# Autodesk Inventor assembly: Assembly3
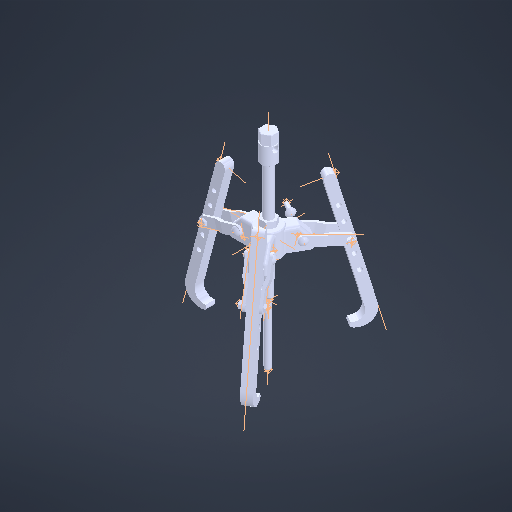
[picture p0: Inventor's stored thumbnail of the model, 512x512]
Saved by Autodesk Inventor 2025.4 (Build 294407000, 407)
## iProperties
Created: 2026-06-25
Part Number: Assembly3
Document SubType Name: Assembly
Designer: VuQuan
Author: VuQuan
## Documents named in this file (9)
- D:\Edu\4CHaUI-Inventor\Test3D\Assembly3.iam
- D:\Edu\4CHaUI-Inventor\Test3D\Bolt.ipt
- D:\Edu\4CHaUI-Inventor\Test3D\Carrier Arm Wheel.ipt
- D:\Edu\4CHaUI-Inventor\Test3D\Handle.ipt
- D:\Edu\4CHaUI-Inventor\Test3D\Hub.ipt
- D:\Edu\4CHaUI-Inventor\Test3D\Locking bar.ipt
- D:\Edu\4CHaUI-Inventor\Test3D\Nut.ipt
- D:\Edu\4CHaUI-Inventor\Test3D\Puller Jaw.ipt
- D:\Edu\4CHaUI-Inventor\Test3D\Screw.ipt
## Components (25 placed, 8 different names)
1. Bolt:1 — Insert:10
2. Carrier Arm Wheel:1 — Insert:2, Insert:7, Insert:11, Insert:21
3. Handle:1
4. Hub:1 — Mate:1, Insert:1, Insert:2, Insert:3, Insert:4, Insert:5, Insert:6
5. Locking bar:1 — Insert:16
6. Nut:1 — Insert:14
7. Puller Jaw:1 — Insert:7, Mate:4
8. Screw:1 — Mate:1
9. Carrier Arm Wheel:2 — Insert:4, Mate:4, Insert:14, Insert:20
10. Carrier Arm Wheel:3 — Insert:5, Insert:8, Insert:12, Insert:17
11. Carrier Arm Wheel:4 — Insert:3, Insert:9, Insert:10, Insert:19
12. Carrier Arm Wheel:5 — Insert:6, Mate:2, Insert:15, Insert:18
13. Carrier Arm Wheel:6 — Insert:1, Mate:3, Insert:13, Insert:16
14. Puller Jaw:2 — Insert:8, Mate:3
15. Puller Jaw:3 — Insert:9, Mate:2
16. Bolt:2 — Insert:12
17. Bolt:3 — Insert:11
18. Nut:2 — Insert:13
19. Nut:3 — Insert:15
20. Locking bar:2 — Insert:17
21. Locking bar:3 — Insert:18
22. Locking bar:4 — Insert:20
23. Locking bar:5
24. Locking bar:6 — Insert:19
25. Locking bar:7 — Insert:21
## Relationships (25: Insert 21, Mate 4)
- Mate:1: Hub:1 ↔ Screw:1
- Insert:1: Hub:1 ↔ Carrier Arm Wheel:6
- Insert:2: Carrier Arm Wheel:1 ↔ Hub:1
- Insert:3: Hub:1 ↔ Carrier Arm Wheel:4
- Insert:4: Hub:1 ↔ Carrier Arm Wheel:2
- Insert:5: Hub:1 ↔ Carrier Arm Wheel:3
- Insert:6: Hub:1 ↔ Carrier Arm Wheel:5
- Insert:7: Carrier Arm Wheel:1 ↔ Puller Jaw:1
- Insert:8: Carrier Arm Wheel:3 ↔ Puller Jaw:2
- Insert:9: Carrier Arm Wheel:4 ↔ Puller Jaw:3
- Mate:2: Carrier Arm Wheel:5 ↔ Puller Jaw:3
- Mate:3: Carrier Arm Wheel:6 ↔ Puller Jaw:2
- Mate:4: Puller Jaw:1 ↔ Carrier Arm Wheel:2
- Insert:10: Bolt:1 ↔ Carrier Arm Wheel:4
- Insert:11: Carrier Arm Wheel:1 ↔ Bolt:3
- Insert:12: Carrier Arm Wheel:3 ↔ Bolt:2
- Insert:13: Carrier Arm Wheel:6 ↔ Nut:2
- Insert:14: Nut:1 ↔ Carrier Arm Wheel:2
- Insert:15: Carrier Arm Wheel:5 ↔ Nut:3
- Insert:16: Locking bar:1 ↔ Carrier Arm Wheel:6
- Insert:17: Carrier Arm Wheel:3 ↔ Locking bar:2
- Insert:18: Carrier Arm Wheel:5 ↔ Locking bar:3
- Insert:19: Carrier Arm Wheel:4 ↔ Locking bar:6
- Insert:20: Carrier Arm Wheel:2 ↔ Locking bar:4
- Insert:21: Carrier Arm Wheel:1 ↔ Locking bar:7
